# Autodesk Inventor assembly: leva_cilindrica2
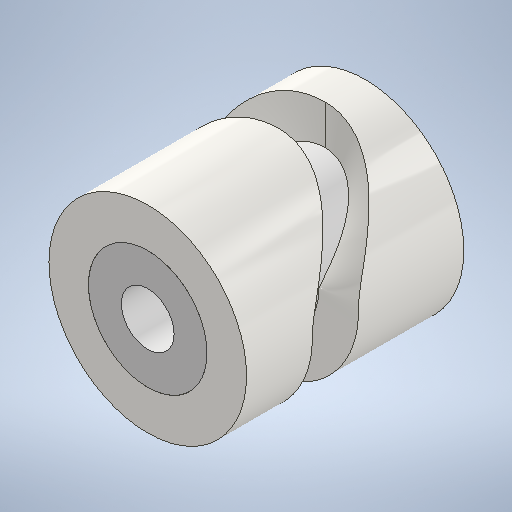
[picture p0: Inventor's stored thumbnail of the model, 512x512]
Saved by Autodesk Inventor 2025.2 (Build 292293000, 293)
## iProperties
Created: 2025-05-16
Part Number: leva_cilindrica2
Document SubType Name: Assembly
Designer: laura
Author: laura
## Documents named in this file (4)
- C:\Users\laura\OneDrive - Universidad de los andes\Documentos\7mo semestre\Dinámica de Maquinaria\Taller 3\leva_cilindrica2.iam
- C:\Users\laura\OneDrive - Universidad de los andes\Documentos\7mo semestre\Dinámica de Maquinaria\Taller 3\Cylindrical Cam2 - Copy.ipt
- C:\Users\laura\OneDrive - Universidad de los andes\Documentos\7mo semestre\Dinámica de Maquinaria\Taller 3\Cylindrical Cam2.ipt
- C:\Users\laura\OneDrive - Universidad de los andes\Documentos\7mo semestre\Dinámica de Maquinaria\Taller 3\Part25.ipt
## Components (3 placed, 2 different names)
1. Cylindrical Cam:1 — Mate:1, Flush:1, Flush:2, Flush:3, Flush:5
2. Cylindrical Cam:2 — Mate:1, Flush:1, Flush:2, Flush:3
3. Part25:1 — Flush:5
## Relationships (5: Flush 4, Mate 1)
- Mate:1: Cylindrical Cam:1 ↔ Cylindrical Cam:2
- Flush:1: Cylindrical Cam:1 ↔ Cylindrical Cam:2
- Flush:2: Cylindrical Cam:1 ↔ Cylindrical Cam:2
- Flush:3 (7 mm): Cylindrical Cam:1 ↔ Cylindrical Cam:2
- Flush:5: Cylindrical Cam:1 ↔ Part25:1
